# Autodesk Inventor assembly: SPE9V1 Freno
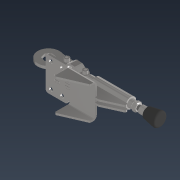
[picture p0: Inventor's stored thumbnail of the model, 180x180]
Saved by Autodesk Inventor 2021.2 (Build 252289000, 289)
## iProperties
Created: 2026-06-23
Part Number: SPE9V1 Freno
Document SubType Name: Assembly
Designer: nelso
Mass: 67.882 g
Surface Area: 387.016 cm^2
Volume: 58.1697 cm^3
Density: 1.16697 g/cm^3
Author: nelso
## Documents named in this file (10)
- C:\Users\Tecnica\OneDrive\Documentos\Mecanica\Soporte-Paciente-Espinografia\Workspace\SPE9V1 Freno.iam
- C:\Users\Tecnica\OneDrive\Documentos\Mecanica\Soporte-Paciente-Espinografia\Workspace\SP35V1 Conductor Hexagonal Freno.ipt
- C:\Users\Tecnica\OneDrive\Documentos\Mecanica\Soporte-Paciente-Espinografia\Workspace\SP34V1 Vastago Freno.ipt
- C:\Users\Tecnica\OneDrive\Documentos\Mecanica\Soporte-Paciente-Espinografia\Workspace\DIN912-M5X0.8L16P.ipt
- C:\Users\Tecnica\OneDrive\Documentos\Mecanica\Soporte-Paciente-Espinografia\Workspace\SP33V1 Viela Freno.ipt
- C:\Users\Tecnica\OneDrive\Documentos\Mecanica\Soporte-Paciente-Espinografia\Workspace\DIN555-5M5X0.8C.ipt
- C:\Users\Tecnica\OneDrive\Documentos\Mecanica\Soporte-Paciente-Espinografia\Workspace\SPE10V1 Soporte Freno (soldadura).iam
- C:\Users\Tecnica\OneDrive\Documentos\Mecanica\Soporte-Paciente-Espinografia\Workspace\SP36V1 Pata Goma Freno.ipt
- C:\Users\Tecnica\OneDrive\Documentos\Mecanica\Soporte-Paciente-Espinografia\Workspace\SP56V1 Ajuste Freno.ipt
- C:\Users\Tecnica\OneDrive\Documentos\Mecanica\Soporte-Paciente-Espinografia\Workspace\DIN934-M8X1.25.ipt
## Components (12 placed, 9 different names)
1. SPE10V1 Soporte Freno (soldadura):1 [sub-assembly]
2. SP33V1 Viela Freno:1 — Mate:69, Mate:70, Mate:71, Mate:78, Mate:79
3. SP33V1 Viela Freno:2 — Mate:72, Mate:73, Mate:74, Mate:75, Mate:76
4. SP34V1 Vastago Freno:1 — Mate:68, Mate:86, Mate:87
5. SP35V1 Conductor Hexagonal Freno:1 — Mate:34, Mate:38, Mate:62, Mate:71, Mate:74
6. SP36V1 Pata Goma Freno:1 — Mate:83, Mate:84
7. DIN912-M5X0.8L16P:1 — Mate:62, Mate:69, Mate:72, Mate:75, Mate:77
8. DIN912-M5X0.8L16P:2 — Mate:68, Mate:70, Mate:73, Mate:76, Mate:80
9. DIN555-5M5X0.8C:1 — Mate:77, Mate:78
10. DIN555-5M5X0.8C:2 — Mate:79, Mate:80
11. SP56V1 Ajuste Freno:1 — Mate:83, Mate:84, Mate:85, Mate:87, Mate:88
12. DIN934-M8X1.25:1 — Mate:85, Mate:86, Mate:88
## Relationships (29: Mate 27, Flush 2)
- [Mate]: SPE10V1 Soporte Freno (soldadura):1
- [Flush]: SPE10V1 Soporte Freno (soldadura):1
- [Mate]: SPE10V1 Soporte Freno (soldadura):1
- Mate:34: SP35V1 Conductor Hexagonal Freno:1
- [Flush] (4 mm): SPE10V1 Soporte Freno (soldadura):1
- [Mate]: SPE10V1 Soporte Freno (soldadura):1
- Mate:38: SP35V1 Conductor Hexagonal Freno:1
- [Mate]: SPE10V1 Soporte Freno (soldadura):1
- [Mate]: SPE10V1 Soporte Freno (soldadura):1 ↔ SP34V1 Vastago Freno:1
- Mate:62: SP35V1 Conductor Hexagonal Freno:1 ↔ DIN912-M5X0.8L16P:1
- Mate:68: SP34V1 Vastago Freno:1 ↔ DIN912-M5X0.8L16P:2
- Mate:69: SP33V1 Viela Freno:1 ↔ DIN912-M5X0.8L16P:1
- Mate:70: SP33V1 Viela Freno:1 ↔ DIN912-M5X0.8L16P:2
- Mate:71: SP33V1 Viela Freno:1 ↔ SP35V1 Conductor Hexagonal Freno:1
- Mate:72: SP33V1 Viela Freno:2 ↔ DIN912-M5X0.8L16P:1
- Mate:73: SP33V1 Viela Freno:2 ↔ DIN912-M5X0.8L16P:2
- Mate:74: SP33V1 Viela Freno:2 ↔ SP35V1 Conductor Hexagonal Freno:1
- Mate:75: SP33V1 Viela Freno:2 ↔ DIN912-M5X0.8L16P:1
- Mate:76: SP33V1 Viela Freno:2 ↔ DIN912-M5X0.8L16P:2
- Mate:77: DIN912-M5X0.8L16P:1 ↔ DIN555-5M5X0.8C:1
- Mate:78: SP33V1 Viela Freno:1 ↔ DIN555-5M5X0.8C:1
- Mate:79: SP33V1 Viela Freno:1 ↔ DIN555-5M5X0.8C:2
- Mate:80: DIN912-M5X0.8L16P:2 ↔ DIN555-5M5X0.8C:2
- Mate:83: SP36V1 Pata Goma Freno:1 ↔ SP56V1 Ajuste Freno:1
- Mate:84: SP36V1 Pata Goma Freno:1 ↔ SP56V1 Ajuste Freno:1
- Mate:85: SP56V1 Ajuste Freno:1 ↔ DIN934-M8X1.25:1
- Mate:86: SP34V1 Vastago Freno:1 ↔ DIN934-M8X1.25:1
- Mate:87: SP34V1 Vastago Freno:1 ↔ SP56V1 Ajuste Freno:1
- Mate:88 (5 mm): SP56V1 Ajuste Freno:1 ↔ DIN934-M8X1.25:1
